# Autodesk Inventor assembly: ArmAssemblyR
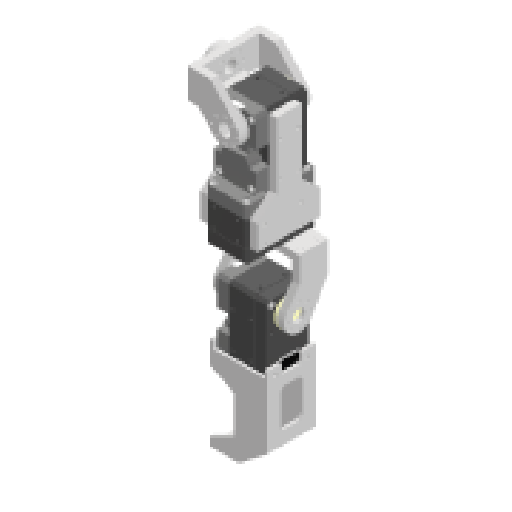
[picture p0: Inventor's stored thumbnail of the model, 512x512]
Saved by Autodesk Inventor 2025.2 (Build 292293000, 293)
## iProperties
Created: 2025-06-27
Part Number: ArmAssemblyR
Document SubType Name: Assembly
Designer: ricoa
Author: ricoa
## Documents named in this file (9)
- C:\Users\ricoa\Desktop\PROYEK AKHIR\project_pororo\Arm\ArmAssemblyR.iam
- C:\Users\ricoa\Desktop\PROYEK AKHIR\project_pororo\Arm\ConnectorBodytoArmR.ipt
- C:\Users\ricoa\Desktop\PROYEK AKHIR\project_pororo\XM430-W350-R\XM430-W350-R\XM430-W350-RR.iam
- C:\Users\ricoa\Desktop\PROYEK AKHIR\project_pororo\Arm\ShoulderSideR.ipt
- C:\Users\ricoa\Desktop\PROYEK AKHIR\project_pororo\Arm\ShoulderFrontR.ipt
- C:\Users\ricoa\Desktop\PROYEK AKHIR\project_pororo\Arm\ConnectortoElbowSideR.ipt
- C:\Users\ricoa\Desktop\PROYEK AKHIR\project_pororo\Arm\ElbowSideR.ipt
- C:\Users\ricoa\Desktop\PROYEK AKHIR\project_pororo\Arm\ElbowTopR.ipt
- C:\Users\ricoa\Desktop\PROYEK AKHIR\project_pororo\Arm\FistR.ipt
## Components (13 placed, 8 different names)
1. ConnectorBodytoArmR:1 — Mate:27, Mate:7, Mate:4
2. XM430-W350-R:1 [sub-assembly] — Mate:39, Mate:38, Mate:37, Mate:14, Flush:5, Mate:10, Mate:9, Flush:3, Mate:13, Mate:12, Mate:11
3. ShoulderSideR:1 — Mate:39, Mate:38, Mate:37, Mate:6, Mate:5, Flush:2
4. ShoulderSideR:2 — Mate:28, Mate:8
5. ShoulderFrontR:1 — Mate:28, Mate:27, Mate:8, Mate:7, Mate:6, Mate:5, Mate:4, Flush:2
6. XM430-W350-R:2 [sub-assembly] — Mate:14, Flush:5, Mate:15, Mate:25, Mate:19, Flush:7
7. ConnectortoElbowSideR:1 — Mate:15, Mate:10, Mate:9, Flush:3
8. ConnectortoElbowSideR:2 — Mate:13, Mate:12, Mate:11
9. XM430-W350-R:3 [sub-assembly] — Mate:23, Mate:22, Flush:9, Mate:33, Mate:36, Mate:37
10. ElbowSideR:1 — Mate:33, Mate:34, Mate:35, Mate:36, Mate:37
11. ElbowSideR:2 — Mate:38, Mate:39
12. ElbowTopR:1 — Mate:25, Mate:19, Flush:7, Mate:34, Mate:35, Mate:38, Mate:39
13. FistR:1 — Mate:23, Mate:22, Flush:9
## Relationships (33: Mate 32, Flush 1)
- Mate:39: XM430-W350-R:1 ↔ ShoulderSideR:1
- Mate:38: XM430-W350-R:1 ↔ ShoulderSideR:1
- Mate:37: XM430-W350-R:1 ↔ ShoulderSideR:1
- Mate:28: ShoulderSideR:2 ↔ ShoulderFrontR:1
- Mate:27: ConnectorBodytoArmR:1 ↔ ShoulderFrontR:1
- Mate:8: ShoulderSideR:2 ↔ ShoulderFrontR:1
- Mate:7: ConnectorBodytoArmR:1 ↔ ShoulderFrontR:1
- Mate:6: ShoulderSideR:1 ↔ ShoulderFrontR:1
- Mate:5: ShoulderSideR:1 ↔ ShoulderFrontR:1
- Mate:4: ConnectorBodytoArmR:1 ↔ ShoulderFrontR:1
- Flush:2 [Mate]: ShoulderSideR:1 ↔ ShoulderFrontR:1
- Mate:14 (2.25 mm): XM430-W350-R:1 ↔ XM430-W350-R:2
- Flush:5 (-6.25 mm): XM430-W350-R:1 ↔ XM430-W350-R:2
- Mate:15: XM430-W350-R:2 ↔ ConnectortoElbowSideR:1
- Mate:10: XM430-W350-R:1 ↔ ConnectortoElbowSideR:1
- Mate:9: XM430-W350-R:1 ↔ ConnectortoElbowSideR:1
- Flush:3 [Mate]: XM430-W350-R:1 ↔ ConnectortoElbowSideR:1
- Mate:13: XM430-W350-R:1 ↔ ConnectortoElbowSideR:2
- Mate:12: XM430-W350-R:1 ↔ ConnectortoElbowSideR:2
- Mate:11: XM430-W350-R:1 ↔ ConnectortoElbowSideR:2
- Mate:25: XM430-W350-R:2 ↔ ElbowTopR:1
- Mate:19: XM430-W350-R:2 ↔ ElbowTopR:1
- Flush:7 [Mate]: XM430-W350-R:2 ↔ ElbowTopR:1
- Mate:23: XM430-W350-R:3 ↔ FistR:1
- Mate:22: XM430-W350-R:3 ↔ FistR:1
- Flush:9 [Mate]: XM430-W350-R:3 ↔ FistR:1
- Mate:33: XM430-W350-R:3 ↔ ElbowSideR:1
- Mate:34: ElbowSideR:1 ↔ ElbowTopR:1
- Mate:35: ElbowSideR:1 ↔ ElbowTopR:1
- Mate:36: XM430-W350-R:3 ↔ ElbowSideR:1
- Mate:37: XM430-W350-R:3 ↔ ElbowSideR:1
- Mate:38: ElbowSideR:2 ↔ ElbowTopR:1
- Mate:39: ElbowSideR:2 ↔ ElbowTopR:1
